# Autodesk Inventor assembly: Seleno_FEA
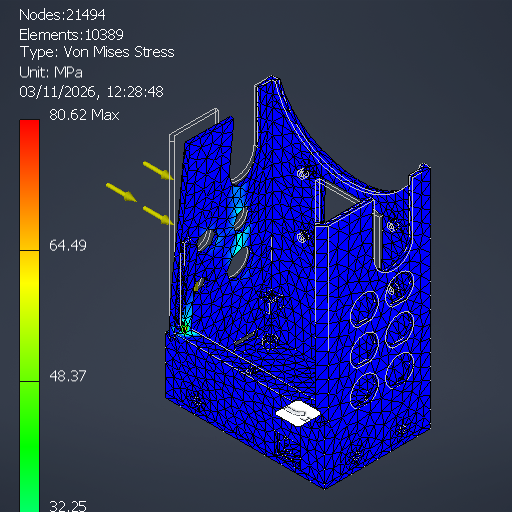
[picture p0: Inventor's stored thumbnail of the model, 512x512]
Saved by Autodesk Inventor 2027.1 (Build 311270010, 270A)
## iProperties
Created: 2026-11-03
Part Number: Seleno_FEA
Document SubType Name: Assembly
Designer: alexg
Mass: 80.2507 g
Surface Area: 651.008 cm^2
Volume: 63.1895 cm^3
Density: 1.27 g/cm^3
Author: alexg
## Documents named in this file (9)
- \\diskstation\Alex Share\ASTRA\inventor\reports\fea\Seleno_FEA.iam
- \\diskstation\Alex Share\ASTRA\inventor\reports\fea\frame_compact_FEA.ipt
- \\diskstation\Alex Share\ASTRA\inventor\reports\fea\base_plate_compact_FEA.ipt
- \\diskstation\Alex Share\ASTRA\inventor\reports\fea\Seleno_FEA\AIP\FEA\flmjpzr5s.fins
- \\diskstation\Alex Share\ASTRA\inventor\reports\fea\Seleno_FEA\AIP\FEA\flmjpzr5s.fsat
- \\diskstation\Alex Share\ASTRA\inventor\reports\fea\Seleno_FEA\AIP\FEA\flmjpzr5s.ftes
- \\diskstation\Alex Share\ASTRA\inventor\reports\fea\Seleno_FEA\AIP\FEA\flmjpzr6o.fwiz
- \\diskstation\Alex Share\ASTRA\inventor\reports\fea\Seleno_FEA\AIP\FEA\flmjpzr7k.fmsh
- \\diskstation\Alex Share\ASTRA\inventor\reports\fea\Seleno_FEA\AIP\FEA\flmjpzr7l.fres
## Components (2 placed, 2 different names)
1. Frame (compact)
2. Base plate (compact)
## Named parameters: sa_0 = 5000, sa_1 = -95 mm, sa_2 = 15 mm, sa_3 = -8 mm, sa_4 = 5000, sa_5 = -95 mm, sa_6 = 37 mm, sa_7 = -8 mm, sa_8 = 5000, sa_9 = -95 mm, sa_10 = 37 mm, sa_11 = 13 mm, sa_12 = 1000, sa_13 = 3000
note: some values were not read from the file. Shown as the stored number, unit unknown: "sa_0", "sa_4", "sa_8", "sa_12", "sa_13".
